# Autodesk Inventor assembly: as_ring
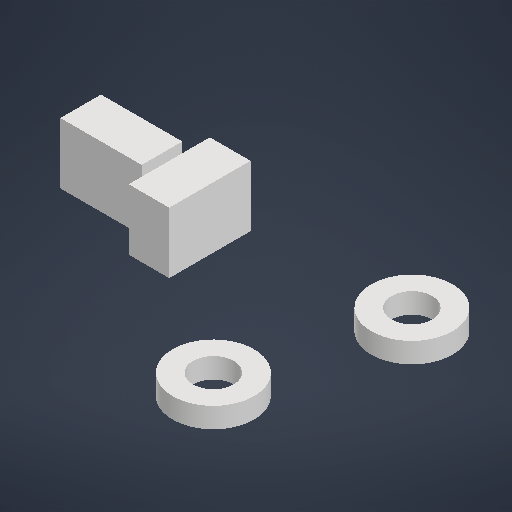
[picture p0: Inventor's stored thumbnail of the model, 512x512]
Saved by Autodesk Inventor 2027 (Build 310192060, 192F)
## iProperties
Created: 2026-10-20
Part Number: as_ring
Document SubType Name: Assembly
Designer: vmiguel
Author: vmiguel
## Documents named in this file (3)
- C:\Users\vmiguel\git\inventor-interface\writer\fixtures\spec\as_ring.iam
- C:\Users\vmiguel\git\inventor-interface\writer\fixtures\spec\ex_rect20.ipt
- C:\Users\vmiguel\git\inventor-interface\writer\fixtures\spec\rv_full.ipt
## Components (4 placed, 2 different names)
1. ex_rect20:1 — Mate:1, Flush:1
2. ex_rect20:2 — Mate:1, Flush:1
3. rv_full:1
4. rv_full:2
## Relationships (2: Mate 1, Flush 1)
- Mate:1 (5 mm): ex_rect20:1 ↔ ex_rect20:2
- Flush:1: ex_rect20:1 ↔ ex_rect20:2
